# Autodesk Inventor assembly: as_imate
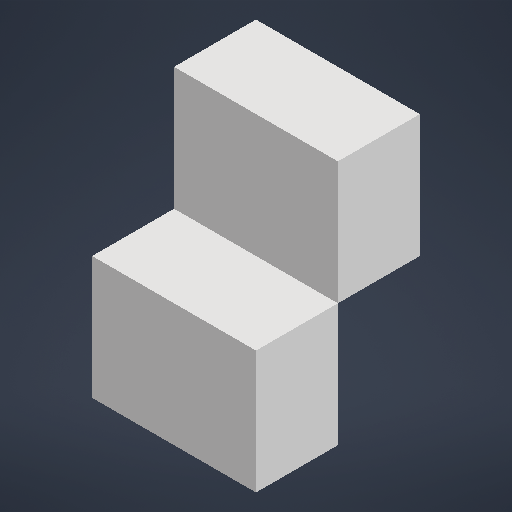
[picture p0: Inventor's stored thumbnail of the model, 512x512]
Saved by Autodesk Inventor 2027 (Build 310192060, 192F)
## iProperties
Created: 2026-10-20
Part Number: as_imate
Document SubType Name: Assembly
Designer: vmiguel
Author: vmiguel
## Documents named in this file (2)
- C:\Users\vmiguel\git\inventor-interface\writer\fixtures\spec\as_imate.iam
- C:\Users\vmiguel\git\inventor-interface\writer\fixtures\spec\it_box.ipt
## Components (2 placed, 1 different names)
1. it_box:1 — Mate:1
2. it_box:2 — Mate:1
## Relationships (1: Mate 1)
- Mate:1: it_box:1 ↔ it_box:2
